# Autodesk Inventor assembly: ARD_Model_v2
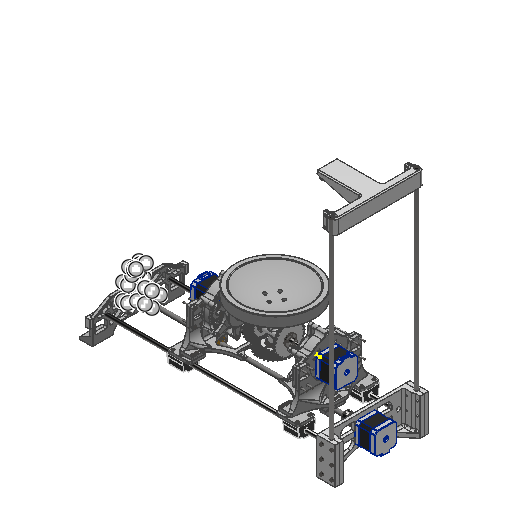
[picture p0: Inventor's stored thumbnail of the model, 512x512]
Saved by Autodesk Inventor 2027 (Build 310192000, 192)
## iProperties
Created: 2026-03-18
Part Number: ARD_Model_v2
Document SubType Name: Assembly
Designer: work
Author: work
## Documents named in this file (34)
- C:\Users\khw\Desktop\ARD_v1\ARD_Model_v2.iam
- C:\Users\khw\Desktop\ARD_v1\ARD_hardware\ARD_Model_v1\1\A.ipt
- C:\Users\khw\Desktop\ARD_v1\ARD_hardware\ARD_Model_v1\C.ipt
- C:\Users\khw\Desktop\ARD_v1\ARD_hardware\ARD_Model_v1\Object\JIS B 1521 SKF (D) - SKF 608-Z.ipt
- C:\Users\khw\Desktop\ARD_v1\ARD_hardware\ARD_Model_v1\5_Co.ipt
- C:\Users\khw\Desktop\ARD_v1\ARD_hardware\ARD_Model_v1\NEMA17.ipt
- C:\Users\khw\Desktop\ARD_v1\ARD_hardware\ARD_Model_v1\1\B.ipt
- C:\Users\khw\Desktop\ARD_v1\ARD_hardware\ARD_Model_v1\Object\T8_LeadNut.ipt
- C:\Users\khw\Desktop\ARD_v1\ARD_hardware\ARD_Model_v1\Object\8T_Shaft.ipt
- C:\Users\khw\Desktop\ARD_v1\ARD_hardware\ARD_Model_v1\Object\T8_BellowsCoulping.ipt
- C:\Users\khw\Desktop\ARD_v1\ARD_hardware\ARD_Model_v1\Object\8T_ScrewShaft.ipt
- C:\Users\khw\Desktop\ARD_v1\ARD_hardware\ARD_Model_v1\Object\LeadWay.ipt
- C:\Users\khw\Desktop\ARD_v1\ARD_hardware\ARD_Model_v1\UR_rail_R_LinearWayCopler_v3.ipt
- C:\Users\khw\Desktop\ARD_v1\ARD_hardware\ARD_Model_v1\Object\KS B 1003 - M 3 x 20.ipt
- C:\Users\khw\Desktop\ARD_v1\ARD_hardware\ARD_Model_v1\Object\KS B 1003 - M 3 x 12.ipt
- C:\Users\khw\Desktop\ARD_v1\ARD_hardware\PL121248m2Drive_v2\pl_v1.iam
- C:\Users\khw\Desktop\ARD_v1\ARD_hardware\ARD_Model_v1\UR_rail_LeadNutHolder_v1.ipt
- C:\Users\khw\Desktop\ARD_v1\ARD_hardware\Rali_v1\stand_v2.ipt
- C:\Users\khw\Desktop\ARD_v1\ARD_hardware\Rali_v1\stand1.ipt
- C:\Users\khw\Desktop\ARD_v1\ARD_hardware\Rali_v1\vl53_hoder.ipt
- C:\Users\khw\Desktop\ARD_v1\ARD_hardware\Rali_v1\stand12.ipt
- C:\Users\khw\Desktop\ARD_v1\ARD_hardware\RA_Project\VL53L0X.ipt
- C:\Users\khw\Desktop\ARD_v1\ARD_hardware\Rali_v1\liner608_holder.ipt
- C:\Users\khw\Desktop\ARD_v1\ARD_hardware\ARD_Model_v1\Object\box big.ipt
- C:\Users\khw\Desktop\ARD_v1\ARD_hardware\ARD_Model_v1\접시.ipt
- C:\Users\khw\Documents\KS B 1003 - M 3 x 10.ipt
- C:\Users\khw\Desktop\ARD_v1\ARD_hardware\Rali_v2\cam holder.ipt
- C:\Users\khw\Desktop\ARD_v1\ARD_hardware\Rali_v2\stand L_v3.ipt
- C:\Users\khw\Desktop\ARD_v1\ARD_hardware\Rali_v2\stand R_v3.ipt
- C:\Users\khw\Desktop\ARD_v1\ARD_hardware\Rali_v2\stand_v3.ipt
- C:\Users\khw\Desktop\ARD_v1\ARD_hardware\ARD_Model_v1\2B_set\AIP\FEA\fdflh83ds.fins
- C:\Users\khw\Desktop\ARD_v1\ARD_hardware\ARD_Model_v1\2B_set\AIP\FEA\fdflh83ds.fsat
- C:\Users\khw\Desktop\ARD_v1\ARD_hardware\ARD_Model_v1\2B_set\AIP\FEA\fdflh83ds.ftes
- C:\Users\khw\Desktop\ARD_v1\ARD_hardware\ARD_Model_v1\2B_set\AIP\FEA\fdflh83ds.fwiz
## Components (135 placed, 29 different names)
1. VL53L0X:1 — 메이트:204, 메이트:205, 각도:21
2. liner608_holder:1 — 메이트:213, 메이트:214, 메이트:215, 메이트:217, 삽입:30, 삽입:31, 삽입:32, 삽입:33
3. box big:1 — 메이트:218, 메이트:226
4. box big:2 — 메이트:227
5. vl53_hoder:1 — 메이트:204, 메이트:205, 각도:21, 삽입:10, 삽입:11, 삽입:12, 삽입:13, 메이트:236, 메이트:237, 메이트:238
6. stand1:1 — 메이트:170, 메이트:171, 메이트:172, 메이트:173, 메이트:174, 메이트:175, 메이트:176, 메이트:177, 메이트:178, 플러쉬:10, 각도:14, 삽입:14, 삽입:15, 삽입:16, 삽입:17, 삽입:18, 삽입:19, 삽입:20, 삽입:21
7. stand1:2 — 메이트:179, 메이트:180, 메이트:181, 메이트:182, 메이트:183, 메이트:184, 메이트:185, 플러쉬:9, 메이트:186, 각도:22, 삽입:5, 삽입:6, 삽입:7, 삽입:8, 삽입:9, 삽입:38, 삽입:39, 삽입:40
8. stand12:2 — 메이트:196, 메이트:197, 메이트:212, 삽입:26, 삽입:27, 삽입:28, 삽입:29, 메이트:226, 메이트:227, 각도:25
9. stand_v2:2 — 메이트:208, 플러쉬:11, 메이트:212, 메이트:213, 메이트:214, 메이트:215, 메이트:218, 메이트:236, 메이트:237, 메이트:238, 각도:24, 각도:25
10. stand_v3:1 — 메이트:228, 각도:23, 메이트:229, 삽입:41, 삽입:42, 삽입:43, 삽입:44, 메이트:230, 메이트:231, 플러쉬:12, 플러쉬:13, 플러쉬:14, 플러쉬:15, 플러쉬:16, 플러쉬:17, 각도:24
11. stand R_v3:1 — 메이트:233, 플러쉬:16, 플러쉬:17, 삽입:51, 삽입:52, 삽입:53, 삽입:54, 삽입:55, 삽입:56
12. stand L_v3:1 — 메이트:232, 플러쉬:14, 플러쉬:15, 삽입:45, 삽입:46, 삽입:47, 삽입:48, 삽입:49, 삽입:50, 각도:26
13. cam holder:1 — 메이트:235, 플러쉬:18
14. 접시:1 — 메이트:222, 메이트:223, 메이트:224, 삽입:22, 삽입:23, 삽입:24, 삽입:25, 각도:26
15. UR_rail_LeadNutHolder_v1:3 — 회전/변환:2, 플러쉬:9, 메이트:186
16. UR_rail_R_LinearWayCopler_v3:1 — 메이트:68, 메이트:69, 메이트:70, 회전:1, 회전:2, 회전:3, 회전:4, 메이트:173, 메이트:174, 메이트:175
17. UR_rail_R_LinearWayCopler_v3:3 — 메이트:176, 메이트:177, 메이트:178
18. B:2
19. A:1 — 메이트:1, 메이트:2, 메이트:11, 메이트:22, 메이트:23, 메이트:163
20. C:1 — 메이트:7, 메이트:8, 메이트:9, 메이트:10, 메이트:11, 메이트:27, 메이트:50, 플러쉬:3
21. A:2 — 메이트:10, 메이트:21, 메이트:24, 메이트:159, 메이트:162
22. 5_Co:4 — 메이트:22, 메이트:23, 메이트:225
23. 5_Co:3 — 메이트:21, 메이트:24, 메이트:159, 메이트:160, 메이트:161
24. B:1 — 메이트:25, 메이트:26, 메이트:27, 각도:22, 메이트:222, 메이트:223, 메이트:224
25. KS B 1003 - M 3 x 12:9
26. KS B 1003 - M 3 x 12:10
27. KS B 1003 - M 3 x 12:11
28. KS B 1003 - M 3 x 12:12
29. KS B 1003 - M 3 x 20:31
30. KS B 1003 - M 3 x 20:32
31. KS B 1003 - M 3 x 20:33
32. KS B 1003 - M 3 x 20:34
33. KS B 1003 - M 3 x 20:35
34. KS B 1003 - M 3 x 20:36
35. KS B 1003 - M 3 x 20:37
36. KS B 1003 - M 3 x 20:38 — 메이트:179
37. KS B 1003 - M 3 x 20:39
38. KS B 1003 - M 3 x 20:40
39. KS B 1003 - M 3 x 20:41 — 메이트:180
40. KS B 1003 - M 3 x 20:42
41. JIS B 1521 SKF (D) - SKF 608-Z:5 — 메이트:216, 메이트:217
42. KS B 1003 - M 3 x 10:37 — 삽입:42
43. KS B 1003 - M 3 x 10:38 — 삽입:43
44. KS B 1003 - M 3 x 10:39 — 삽입:44
45. KS B 1003 - M 3 x 10:40 — 삽입:46
46. KS B 1003 - M 3 x 10:41 — 삽입:47
47. KS B 1003 - M 3 x 10:42 — 삽입:48
48. KS B 1003 - M 3 x 10:43 — 삽입:49
49. KS B 1003 - M 3 x 10:44 — 삽입:50
50. KS B 1003 - M 3 x 10:45 — 삽입:51
51. KS B 1003 - M 3 x 10:46 — 삽입:52
52. KS B 1003 - M 3 x 10:47 — 삽입:53
53. KS B 1003 - M 3 x 10:48 — 삽입:54
54. KS B 1003 - M 3 x 10:49 — 삽입:55
55. KS B 1003 - M 3 x 10:50 — 삽입:56
56. KS B 1003 - M 3 x 10:1 — 삽입:5
57. KS B 1003 - M 3 x 10:2 — 삽입:6
58. KS B 1003 - M 3 x 10:3 — 삽입:7
59. KS B 1003 - M 3 x 10:4 — 삽입:8
60. KS B 1003 - M 3 x 10:5 — 삽입:9
61. KS B 1003 - M 3 x 10:6 — 삽입:10
62. KS B 1003 - M 3 x 10:7 — 삽입:11
63. KS B 1003 - M 3 x 10:8 — 삽입:12
64. KS B 1003 - M 3 x 10:9 — 삽입:13
65. KS B 1003 - M 3 x 10:10 — 삽입:14
66. KS B 1003 - M 3 x 10:11 — 삽입:15
67. KS B 1003 - M 3 x 10:12 — 삽입:16
68. KS B 1003 - M 3 x 10:13 — 삽입:17
69. KS B 1003 - M 3 x 10:14 — 삽입:18
70. KS B 1003 - M 3 x 10:15 — 삽입:19
71. KS B 1003 - M 3 x 10:16 — 삽입:20
72. KS B 1003 - M 3 x 10:17 — 삽입:21
73. KS B 1003 - M 3 x 10:18 — 삽입:22
74. KS B 1003 - M 3 x 10:19 — 삽입:23
75. KS B 1003 - M 3 x 10:20 — 삽입:24
76. KS B 1003 - M 3 x 10:21 — 삽입:25
77. KS B 1003 - M 3 x 10:22 — 삽입:26
78. KS B 1003 - M 3 x 10:23 — 삽입:27
79. KS B 1003 - M 3 x 10:24 — 삽입:28
80. KS B 1003 - M 3 x 10:25 — 삽입:29
81. KS B 1003 - M 3 x 10:26 — 삽입:30
82. KS B 1003 - M 3 x 10:27 — 삽입:31
83. KS B 1003 - M 3 x 10:28 — 삽입:32
84. KS B 1003 - M 3 x 10:29 — 삽입:33
85. KS B 1003 - M 3 x 10:30 — 삽입:41
86. KS B 1003 - M 3 x 10:31 — 삽입:45
87. KS B 1003 - M 3 x 10:34 — 삽입:38
88. KS B 1003 - M 3 x 10:35 — 삽입:39
89. KS B 1003 - M 3 x 10:36 — 삽입:40
90. KS B 1003 - M 3 x 20:27
91. KS B 1003 - M 3 x 20:28
92. KS B 1003 - M 3 x 20:29
93. KS B 1003 - M 3 x 20:30
94. KS B 1003 - M 3 x 20:18 — 회전:31
95. KS B 1003 - M 3 x 20:19 — 회전:32
96. KS B 1003 - M 3 x 20:20 — 삽입:1
97. KS B 1003 - M 3 x 20:21 — 회전:34
98. KS B 1003 - M 3 x 20:22 — 삽입:2, 메이트:171
99. KS B 1003 - M 3 x 20:24 — 회전:35
100. KS B 1003 - M 3 x 20:25 — 회전:33, 메이트:170
101. KS B 1003 - M 3 x 20:26 — 회전:36
102. KS B 1003 - M 3 x 12:8 — 회전:20
103. KS B 1003 - M 3 x 12:5
104. KS B 1003 - M 3 x 12:6
105. KS B 1003 - M 3 x 12:7 — 메이트:134
106. KS B 1003 - M 3 x 20:1 — 회전:1
107. KS B 1003 - M 3 x 20:3 — 회전:3
108. KS B 1003 - M 3 x 20:4 — 회전:2
109. KS B 1003 - M 3 x 20:5 — 회전:4
110. JIS B 1521 SKF (D) - SKF 608-Z:4 — 메이트:50, 플러쉬:3
111. KS B 1003 - M 3 x 20:13
112. KS B 1003 - M 3 x 20:12
113. KS B 1003 - M 3 x 20:11
114. KS B 1003 - M 3 x 20:10
115. 8T_Shaft:3 — 메이트:230, 플러쉬:12, 메이트:232
116. 8T_Shaft:4 — 메이트:231, 플러쉬:13, 메이트:233, 메이트:235, 플러쉬:18
117. UR_rail_LeadNutHolder_v1:2 — 메이트:132, 메이트:133, 메이트:134, 플러쉬:10, 각도:14
118. LeadWay:5 — 메이트:156
119. UR_rail_R_LinearWayCopler_v3:5 — 메이트:181, 메이트:182
120. T8_LeadNut:3 — 메이트:187
121. LeadWay:6 — 메이트:157
122. UR_rail_R_LinearWayCopler_v3:6 — 메이트:183, 메이트:184
123. pl_v1:2 [sub-assembly] — 메이트:161, 메이트:162, 메이트:185
124. pl_v1:1 [sub-assembly] — 회전:31, 회전:32, 삽입:1, 삽입:2, 회전:33, 회전:34, 회전:35, 회전:36, 메이트:160, 메이트:163, 메이트:172, 메이트:225
125. T8_LeadNut:2 — 회전:20, 메이트:132, 메이트:133, 메이트:158
126. 8T_Shaft:2 — 플러쉬:7, 메이트:156, 메이트:197, 플러쉬:11
127. LeadWay:3
128. NEMA17:3 — 메이트:110, 메이트:111, 각도:10, 각도:23, 메이트:229
129. 8T_Shaft:1 — 메이트:71, 플러쉬:7, 메이트:157
130. T8_BellowsCoulping:1 — 메이트:84, 메이트:85, 메이트:110, 메이트:111, 회전:4, 각도:10, 회전/변환:2, 메이트:228
131. 8T_ScrewShaft:1 — 메이트:84, 메이트:85, 회전:4, 메이트:158, 메이트:187, 메이트:196, 메이트:208, 메이트:216
132. LeadWay:1 — 메이트:68, 메이트:69, 메이트:70, 메이트:71
133. JIS B 1521 SKF (D) - SKF 608-Z:2 — 메이트:8
134. JIS B 1521 SKF (D) - SKF 608-Z:3 — 메이트:7, 메이트:25, 메이트:26
135. JIS B 1521 SKF (D) - SKF 608-Z:1 — 메이트:1, 메이트:2, 메이트:9
## Relationships (207: Mate 97, Insert 52, RevoluteJoint 34, Flush 12, Angle 8, WeldJoint 2, RelateRotation 1, RelateRotateTranslate 1)
- 메이트:1 [Mate]: A:1 ↔ JIS B 1521 SKF (D) - SKF 608-Z:1
- 메이트:2 [Mate]: A:1 ↔ JIS B 1521 SKF (D) - SKF 608-Z:1
- [Mate]: A:2 ↔ JIS B 1521 SKF (D) - SKF 608-Z:2
- [Mate]: A:2 ↔ JIS B 1521 SKF (D) - SKF 608-Z:2
- 메이트:7 [Mate]: C:1 ↔ JIS B 1521 SKF (D) - SKF 608-Z:3
- 메이트:8 [Mate]: C:1 ↔ JIS B 1521 SKF (D) - SKF 608-Z:2
- 메이트:9 [Mate]: C:1 ↔ JIS B 1521 SKF (D) - SKF 608-Z:1
- 메이트:10 [Mate]: C:1 ↔ A:2
- 메이트:11 [Mate]: A:1 ↔ C:1
- 메이트:21 [Mate]: A:2 ↔ 5_Co:3
- 메이트:22 [Mate]: A:1 ↔ 5_Co:4
- 메이트:23 [Mate]: A:1 ↔ 5_Co:4
- 메이트:24 [Mate]: A:2 ↔ 5_Co:3
- 메이트:25 [Mate]: B:1 ↔ JIS B 1521 SKF (D) - SKF 608-Z:3
- 메이트:26 [Mate]: B:1 ↔ JIS B 1521 SKF (D) - SKF 608-Z:3
- 메이트:27 [Mate]: C:1 ↔ B:1
- [Mate]: B:2 ↔ JIS B 1521 SKF (D) - SKF 608-Z:4
- [Mate]: B:2 ↔ JIS B 1521 SKF (D) - SKF 608-Z:4
- 메이트:50 [Mate]: C:1 ↔ JIS B 1521 SKF (D) - SKF 608-Z:4
- 플러쉬:3 [Flush]: C:1 ↔ JIS B 1521 SKF (D) - SKF 608-Z:4
- 메이트:68 [Mate]: UR_rail_R_LinearWayCopler_v3:1 ↔ LeadWay:1
- 메이트:69 [Mate]: UR_rail_R_LinearWayCopler_v3:1 ↔ LeadWay:1
- 메이트:70 [Mate]: UR_rail_R_LinearWayCopler_v3:1 ↔ LeadWay:1
- 메이트:71 [Mate]: 8T_Shaft:1 ↔ LeadWay:1
- 회전:1 [RevoluteJoint]: UR_rail_R_LinearWayCopler_v3:1 ↔ KS B 1003 - M 3 x 20:1
- 회전:2 [RevoluteJoint]: UR_rail_R_LinearWayCopler_v3:1 ↔ KS B 1003 - M 3 x 20:4
- 회전:3 [RevoluteJoint]: UR_rail_R_LinearWayCopler_v3:1 ↔ KS B 1003 - M 3 x 20:3
- 회전:4 [RevoluteJoint]: UR_rail_R_LinearWayCopler_v3:1 ↔ KS B 1003 - M 3 x 20:5
- 메이트:84 [Mate]: T8_BellowsCoulping:1 ↔ 8T_ScrewShaft:1
- 메이트:85 [Mate] (-10 mm): T8_BellowsCoulping:1 ↔ 8T_ScrewShaft:1
- [RevoluteJoint]: KS B 1003 - M 3 x 12:5 ↔ T8_LeadNut:2
- [WeldJoint]: KS B 1003 - M 3 x 12:6 ↔ T8_LeadNut:2
- [RevoluteJoint]: KS B 1003 - M 3 x 12:7 ↔ T8_LeadNut:2
- 회전:20 [RevoluteJoint]: KS B 1003 - M 3 x 12:8 ↔ T8_LeadNut:2
- [Mate]: UR_rail_R_LinearWayCopler_v3:3 ↔ LeadWay:3
- [Mate]: UR_rail_R_LinearWayCopler_v3:3 ↔ LeadWay:3
- [Mate]: UR_rail_R_LinearWayCopler_v3:3 ↔ LeadWay:3
- [Mate]: 8T_Shaft:2 ↔ LeadWay:3
- [RevoluteJoint]: UR_rail_R_LinearWayCopler_v3:3 ↔ KS B 1003 - M 3 x 20:10
- [RevoluteJoint]: UR_rail_R_LinearWayCopler_v3:3 ↔ KS B 1003 - M 3 x 20:12
- [RevoluteJoint]: UR_rail_R_LinearWayCopler_v3:3 ↔ KS B 1003 - M 3 x 20:11
- [RevoluteJoint]: UR_rail_R_LinearWayCopler_v3:3 ↔ KS B 1003 - M 3 x 20:13
- 플러쉬:7 [Flush]: 8T_Shaft:2 ↔ 8T_Shaft:1
- 메이트:110 [Mate]: NEMA17:3 ↔ T8_BellowsCoulping:1
- 메이트:111 [Mate] (-10 mm): NEMA17:3 ↔ T8_BellowsCoulping:1
- 회전:4 [RelateRotation] (1 ul): T8_BellowsCoulping:1 ↔ 8T_ScrewShaft:1
- 각도:10 [Angle] (0 deg): NEMA17:3 ↔ T8_BellowsCoulping:1
- 회전:31 [RevoluteJoint]: KS B 1003 - M 3 x 20:18 ↔ pl_v1:1
- 회전:32 [RevoluteJoint]: KS B 1003 - M 3 x 20:19 ↔ pl_v1:1
- 삽입:1 [Insert]: KS B 1003 - M 3 x 20:20 ↔ pl_v1:1
- 삽입:2 [Insert]: KS B 1003 - M 3 x 20:22 ↔ pl_v1:1
- 회전:33 [RevoluteJoint]: KS B 1003 - M 3 x 20:25 ↔ pl_v1:1
- 회전:34 [RevoluteJoint]: KS B 1003 - M 3 x 20:21 ↔ pl_v1:1
- 회전:35 [RevoluteJoint]: KS B 1003 - M 3 x 20:24 ↔ pl_v1:1
- 회전:36 [RevoluteJoint]: KS B 1003 - M 3 x 20:26 ↔ pl_v1:1
- 메이트:132 [Mate]: UR_rail_LeadNutHolder_v1:2 ↔ T8_LeadNut:2
- 메이트:133 [Mate]: UR_rail_LeadNutHolder_v1:2 ↔ T8_LeadNut:2
- 메이트:134 [Mate]: KS B 1003 - M 3 x 12:7 ↔ UR_rail_LeadNutHolder_v1:2
- [Mate]: LeadWay:5 ↔ UR_rail_R_LinearWayCopler_v3:5
- [Mate]: LeadWay:5 ↔ UR_rail_R_LinearWayCopler_v3:5
- [Mate]: LeadWay:5 ↔ UR_rail_R_LinearWayCopler_v3:5
- [RevoluteJoint]: KS B 1003 - M 3 x 20:27 ↔ UR_rail_R_LinearWayCopler_v3:5
- [RevoluteJoint]: KS B 1003 - M 3 x 20:29 ↔ UR_rail_R_LinearWayCopler_v3:5
- [RevoluteJoint]: KS B 1003 - M 3 x 20:28 ↔ UR_rail_R_LinearWayCopler_v3:5
- [RevoluteJoint]: KS B 1003 - M 3 x 20:30 ↔ UR_rail_R_LinearWayCopler_v3:5
- [RevoluteJoint]: KS B 1003 - M 3 x 12:9 ↔ T8_LeadNut:3
- [WeldJoint]: KS B 1003 - M 3 x 12:10 ↔ T8_LeadNut:3
- [RevoluteJoint]: KS B 1003 - M 3 x 12:11 ↔ T8_LeadNut:3
- [RevoluteJoint]: KS B 1003 - M 3 x 12:12 ↔ T8_LeadNut:3
- [Mate]: LeadWay:6 ↔ UR_rail_R_LinearWayCopler_v3:6
- [Mate]: LeadWay:6 ↔ UR_rail_R_LinearWayCopler_v3:6
- [Mate]: LeadWay:6 ↔ UR_rail_R_LinearWayCopler_v3:6
- [RevoluteJoint]: KS B 1003 - M 3 x 20:31 ↔ UR_rail_R_LinearWayCopler_v3:6
- [RevoluteJoint]: KS B 1003 - M 3 x 20:33 ↔ UR_rail_R_LinearWayCopler_v3:6
- [RevoluteJoint]: KS B 1003 - M 3 x 20:32 ↔ UR_rail_R_LinearWayCopler_v3:6
- [RevoluteJoint]: KS B 1003 - M 3 x 20:34 ↔ UR_rail_R_LinearWayCopler_v3:6
- [RevoluteJoint]: KS B 1003 - M 3 x 20:35 ↔ pl_v1:2
- [RevoluteJoint]: KS B 1003 - M 3 x 20:36 ↔ pl_v1:2
- [Insert]: KS B 1003 - M 3 x 20:37 ↔ pl_v1:2
- [Insert]: KS B 1003 - M 3 x 20:39 ↔ pl_v1:2
- [RevoluteJoint]: KS B 1003 - M 3 x 20:41 ↔ pl_v1:2
- [RevoluteJoint]: KS B 1003 - M 3 x 20:38 ↔ pl_v1:2
- [RevoluteJoint]: KS B 1003 - M 3 x 20:40 ↔ pl_v1:2
- [RevoluteJoint]: KS B 1003 - M 3 x 20:42 ↔ pl_v1:2
- [Mate]: UR_rail_LeadNutHolder_v1:3 ↔ T8_LeadNut:3
- [Mate]: UR_rail_LeadNutHolder_v1:3 ↔ T8_LeadNut:3
- [Mate]: UR_rail_LeadNutHolder_v1:3 ↔ KS B 1003 - M 3 x 12:11
- 메이트:156 [Mate]: LeadWay:5 ↔ 8T_Shaft:2
- 메이트:157 [Mate]: LeadWay:6 ↔ 8T_Shaft:1
- 메이트:158 [Mate]: T8_LeadNut:2 ↔ 8T_ScrewShaft:1
- 메이트:159 [Mate]: A:2 ↔ 5_Co:3
- 메이트:160 [Mate]: 5_Co:3 ↔ pl_v1:1
- 메이트:161 [Mate]: 5_Co:3 ↔ pl_v1:2
- 메이트:162 [Mate]: A:2 ↔ pl_v1:2
- 메이트:163 [Mate]: A:1 ↔ pl_v1:1
- 회전/변환:2 [RelateRotateTranslate] (8 mm): UR_rail_LeadNutHolder_v1:3 ↔ T8_BellowsCoulping:1
- 메이트:170 [Mate]: stand1:1 ↔ KS B 1003 - M 3 x 20:25
- 메이트:171 [Mate]: stand1:1 ↔ KS B 1003 - M 3 x 20:22
- 메이트:172 [Mate]: stand1:1 ↔ pl_v1:1
- 메이트:173 [Mate]: stand1:1 ↔ UR_rail_R_LinearWayCopler_v3:1
- 메이트:174 [Mate]: stand1:1 ↔ UR_rail_R_LinearWayCopler_v3:1
- 메이트:175 [Mate]: stand1:1 ↔ UR_rail_R_LinearWayCopler_v3:1
- 메이트:176 [Mate]: stand1:1 ↔ UR_rail_R_LinearWayCopler_v3:3
- 메이트:177 [Mate]: stand1:1 ↔ UR_rail_R_LinearWayCopler_v3:3
- 메이트:178 [Mate]: stand1:1 ↔ UR_rail_R_LinearWayCopler_v3:3
- 메이트:179 [Mate]: stand1:2 ↔ KS B 1003 - M 3 x 20:38
- 메이트:180 [Mate]: stand1:2 ↔ KS B 1003 - M 3 x 20:41
- 메이트:181 [Mate]: stand1:2 ↔ UR_rail_R_LinearWayCopler_v3:5
- 메이트:182 [Mate]: stand1:2 ↔ UR_rail_R_LinearWayCopler_v3:5
- 메이트:183 [Mate]: stand1:2 ↔ UR_rail_R_LinearWayCopler_v3:6
- 메이트:184 [Mate]: stand1:2 ↔ UR_rail_R_LinearWayCopler_v3:6
- 메이트:185 [Mate]: stand1:2 ↔ pl_v1:2
- 플러쉬:9 [Flush]: stand1:2 ↔ UR_rail_LeadNutHolder_v1:3
- 메이트:186 [Mate]: stand1:2 ↔ UR_rail_LeadNutHolder_v1:3
- 메이트:187 [Mate]: T8_LeadNut:3 ↔ 8T_ScrewShaft:1
- 플러쉬:10 [Flush]: stand1:1 ↔ UR_rail_LeadNutHolder_v1:2
- 각도:14 [Angle] (0 deg): stand1:1 ↔ UR_rail_LeadNutHolder_v1:2
- 메이트:196 [Mate]: stand12:2 ↔ 8T_ScrewShaft:1
- 메이트:197 [Mate] (-32 mm): stand12:2 ↔ 8T_Shaft:2
- 메이트:204 [Mate]: VL53L0X:1 ↔ vl53_hoder:1
- 메이트:205 [Mate]: VL53L0X:1 ↔ vl53_hoder:1
- 각도:21 [Angle] (0 deg): VL53L0X:1 ↔ vl53_hoder:1
- 각도:22 [Angle] (0 deg): stand1:2 ↔ B:1
- 메이트:208 [Mate]: stand_v2:2 ↔ 8T_ScrewShaft:1
- 플러쉬:11 [Flush]: stand_v2:2 ↔ 8T_Shaft:2
- 메이트:212 [Mate]: stand12:2 ↔ stand_v2:2
- 메이트:213 [Mate]: liner608_holder:1 ↔ stand_v2:2
- 메이트:214 [Mate]: liner608_holder:1 ↔ stand_v2:2
- 메이트:215 [Mate]: liner608_holder:1 ↔ stand_v2:2
- 메이트:216 [Mate]: JIS B 1521 SKF (D) - SKF 608-Z:5 ↔ 8T_ScrewShaft:1
- 메이트:217 [Mate]: liner608_holder:1 ↔ JIS B 1521 SKF (D) - SKF 608-Z:5
- 메이트:218 [Mate]: box big:1 ↔ stand_v2:2
- 메이트:222 [Mate]: 접시:1 ↔ B:1
- 메이트:223 [Mate]: 접시:1 ↔ B:1
- 메이트:224 [Mate]: 접시:1 ↔ B:1
- 삽입:5 [Insert]: stand1:2 ↔ KS B 1003 - M 3 x 10:1
- 삽입:6 [Insert]: stand1:2 ↔ KS B 1003 - M 3 x 10:2
- 삽입:7 [Insert]: stand1:2 ↔ KS B 1003 - M 3 x 10:3
- 삽입:8 [Insert]: stand1:2 ↔ KS B 1003 - M 3 x 10:4
- 삽입:9 [Insert]: stand1:2 ↔ KS B 1003 - M 3 x 10:5
- 삽입:10 [Insert]: vl53_hoder:1 ↔ KS B 1003 - M 3 x 10:6
- 삽입:11 [Insert]: vl53_hoder:1 ↔ KS B 1003 - M 3 x 10:7
- 삽입:12 [Insert]: vl53_hoder:1 ↔ KS B 1003 - M 3 x 10:8
- 삽입:13 [Insert]: vl53_hoder:1 ↔ KS B 1003 - M 3 x 10:9
- 삽입:14 [Insert]: stand1:1 ↔ KS B 1003 - M 3 x 10:10
- 삽입:15 [Insert]: stand1:1 ↔ KS B 1003 - M 3 x 10:11
- 삽입:16 [Insert]: stand1:1 ↔ KS B 1003 - M 3 x 10:12
- 삽입:17 [Insert]: stand1:1 ↔ KS B 1003 - M 3 x 10:13
- 삽입:18 [Insert]: stand1:1 ↔ KS B 1003 - M 3 x 10:14
- 삽입:19 [Insert]: stand1:1 ↔ KS B 1003 - M 3 x 10:15
- 삽입:20 [Insert]: stand1:1 ↔ KS B 1003 - M 3 x 10:16
- 삽입:21 [Insert]: stand1:1 ↔ KS B 1003 - M 3 x 10:17
- 삽입:22 [Insert]: 접시:1 ↔ KS B 1003 - M 3 x 10:18
- 삽입:23 [Insert]: 접시:1 ↔ KS B 1003 - M 3 x 10:19
- 삽입:24 [Insert]: 접시:1 ↔ KS B 1003 - M 3 x 10:20
- 삽입:25 [Insert]: 접시:1 ↔ KS B 1003 - M 3 x 10:21
- 삽입:26 [Insert]: stand12:2 ↔ KS B 1003 - M 3 x 10:22
- 삽입:27 [Insert]: stand12:2 ↔ KS B 1003 - M 3 x 10:23
- 삽입:28 [Insert]: stand12:2 ↔ KS B 1003 - M 3 x 10:24
- 삽입:29 [Insert]: stand12:2 ↔ KS B 1003 - M 3 x 10:25
- 삽입:30 [Insert]: liner608_holder:1 ↔ KS B 1003 - M 3 x 10:26
- 삽입:31 [Insert]: liner608_holder:1 ↔ KS B 1003 - M 3 x 10:27
- 삽입:32 [Insert]: liner608_holder:1 ↔ KS B 1003 - M 3 x 10:28
- 삽입:33 [Insert]: liner608_holder:1 ↔ KS B 1003 - M 3 x 10:29
- 삽입:38 [Insert]: stand1:2 ↔ KS B 1003 - M 3 x 10:34
- 삽입:39 [Insert]: stand1:2 ↔ KS B 1003 - M 3 x 10:35
- 삽입:40 [Insert]: stand1:2 ↔ KS B 1003 - M 3 x 10:36
- 메이트:225 [Mate]: 5_Co:4 ↔ pl_v1:1
- 메이트:226 [Mate]: box big:1 ↔ stand12:2
- 메이트:227 [Mate]: box big:2 ↔ stand12:2
- 메이트:228 [Mate]: stand_v3:1 ↔ T8_BellowsCoulping:1
- 각도:23 [Angle] (0 deg): stand_v3:1 ↔ NEMA17:3
- 메이트:229 [Mate]: stand_v3:1 ↔ NEMA17:3
- 삽입:41 [Insert]: stand_v3:1 ↔ KS B 1003 - M 3 x 10:30
- 삽입:42 [Insert]: stand_v3:1 ↔ KS B 1003 - M 3 x 10:37
- 삽입:43 [Insert]: stand_v3:1 ↔ KS B 1003 - M 3 x 10:38
- 삽입:44 [Insert]: stand_v3:1 ↔ KS B 1003 - M 3 x 10:39
- 메이트:230 [Mate]: stand_v3:1 ↔ 8T_Shaft:3
- 메이트:231 [Mate]: stand_v3:1 ↔ 8T_Shaft:4
- 플러쉬:12 [Flush]: stand_v3:1 ↔ 8T_Shaft:3
- 플러쉬:13 [Flush]: stand_v3:1 ↔ 8T_Shaft:4
- 메이트:232 [Mate]: stand L_v3:1 ↔ 8T_Shaft:3
- 플러쉬:14 [Flush]: stand_v3:1 ↔ stand L_v3:1
- 플러쉬:15 [Flush]: stand_v3:1 ↔ stand L_v3:1
- 메이트:233 [Mate]: stand R_v3:1 ↔ 8T_Shaft:4
- 플러쉬:16 [Flush]: stand_v3:1 ↔ stand R_v3:1
- 플러쉬:17 [Flush]: stand_v3:1 ↔ stand R_v3:1
- 메이트:235 [Mate]: cam holder:1 ↔ 8T_Shaft:4
- 플러쉬:18 [Flush]: cam holder:1 ↔ 8T_Shaft:4
- 삽입:45 [Insert]: stand L_v3:1 ↔ KS B 1003 - M 3 x 10:31
- 삽입:46 [Insert]: stand L_v3:1 ↔ KS B 1003 - M 3 x 10:40
- 삽입:47 [Insert]: stand L_v3:1 ↔ KS B 1003 - M 3 x 10:41
- 삽입:48 [Insert]: stand L_v3:1 ↔ KS B 1003 - M 3 x 10:42
- 삽입:49 [Insert]: stand L_v3:1 ↔ KS B 1003 - M 3 x 10:43
- 삽입:50 [Insert]: stand L_v3:1 ↔ KS B 1003 - M 3 x 10:44
- 삽입:51 [Insert]: stand R_v3:1 ↔ KS B 1003 - M 3 x 10:45
- 삽입:52 [Insert]: stand R_v3:1 ↔ KS B 1003 - M 3 x 10:46
- 삽입:53 [Insert]: stand R_v3:1 ↔ KS B 1003 - M 3 x 10:47
- 삽입:54 [Insert]: stand R_v3:1 ↔ KS B 1003 - M 3 x 10:48
- 삽입:55 [Insert]: stand R_v3:1 ↔ KS B 1003 - M 3 x 10:49
- 삽입:56 [Insert]: stand R_v3:1 ↔ KS B 1003 - M 3 x 10:50
- 메이트:236 [Mate]: vl53_hoder:1 ↔ stand_v2:2
- 메이트:237 [Mate]: vl53_hoder:1 ↔ stand_v2:2
- 메이트:238 [Mate]: vl53_hoder:1 ↔ stand_v2:2
- 각도:24 [Angle] (0 deg): stand_v2:2 ↔ stand_v3:1
- 각도:25 [Angle] (0 deg): stand12:2 ↔ stand_v2:2
- 각도:26 [Angle] (0 deg): stand L_v3:1 ↔ 접시:1
## Named parameters: d3_d1 = 0 mm, d4_d2 = 0 mm, sa_0 = 10000, d161_d108 = 0 mm, d162_d109 = 0 mm, d267_d244 = 0 mm, d268_d245 = 96.496517 deg, d269_d246 = 0 mm, d270_d249 = 0 mm, d271_d250 = -58.121074 deg, d283_d196 = 0 mm, d284_d197 = 0 mm, d285_d198 = 0 mm, d286_d199 = 0 mm, d287_d200 = 0 mm, d288_d201 = -55.430214 deg, d289_d202 = 0 mm, d290_d203 = -178.015525 deg, d291_d204 = 0 mm, d292_d205 = -44.908561 deg, d293_d206 = 0 mm, d294_d207 = 143.857015 deg, d409_d378 = 0 mm, d410_d379 = 45.354722 deg, d411_d380 = 0 mm, d412_d381 = 110.968184 deg, d413_d382 = 0 mm, d414_d383 = 0 mm, d415_d384 = 0 mm, d416_d385 = 27.068236 deg, d417_d386 = 0 mm, d418_d387 = -166.736049 deg, d419_d267_d244 = 0 mm, d420_d268_d245 = -92.987832 deg, d421_d269_d246 = 0 mm, d422_d270_d249 = 0 mm, d423_d271_d250 = -133.982057 deg, d424_d277 = 0 mm, d425_d278 = -9.647554 deg, d426_d283_d196 = 0 mm, d427_d284_d197 = 0 mm, d428_d285_d198 = 0 mm, d429_d287_d200 = 0 mm, d430_d288_d201 = -75.925406 deg, d431_d289_d202 = 0 mm, d432_d290_d203 = -14.846249 deg, d433_d291_d204 = 0 mm, d434_d292_d205 = 115.395621 deg, d435_d293_d206 = 0 mm, d436_d294_d207 = 143.303974 deg, d437_d206 = 0 mm, d438_d207 = 52.349467 deg, d439_d196 = 0 mm, d440_d197 = 0 mm, d441_d198 = 0 mm, d442_d200 = 0 mm, d443_d201 = 94.724345 deg, d444_d202 = 0 mm, d445_d203 = 161.012813 deg, d446_d204 = 0 mm, d447_d205 = -95.855516 deg, d448_d388 = 0 mm, d449_d389 = -57.609371 deg, d450_d390 = 0 mm, d451_d391 = 88.83408 deg, d458_d403 = 0 mm, d459_d404 = 0 mm, d460_d405 = 0 mm
note: some values were not read from the file. Shown as the stored number, unit unknown: "sa_0".
